# Autodesk Inventor assembly: full_adder
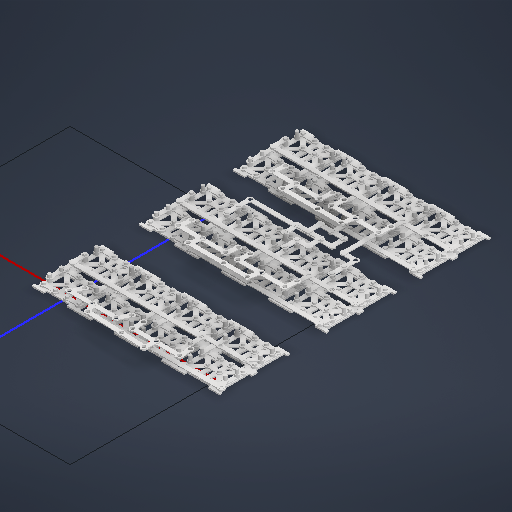
[picture p0: Inventor's stored thumbnail of the model, 512x512]
Saved by Autodesk Inventor 2025.4 (Build 294407000, 407)
## iProperties
Created: 2026-09-28
Part Number: full_adder
Document SubType Name: Assembly
Designer: User
Author: User
## Documents named in this file (3)
- G:\projects\primary\mechanical-computer\mechanics\modules\full_adder.iam
- G:\projects\primary\mechanical-computer\mechanics\gates\decoder.iam
- G:\projects\primary\mechanical-computer\mechanics\gates\gate_and-a.iam
## Components (4 placed, 2 different names)
1. decoder:1 [sub-assembly] — Flush:1, Flush:3
2. decoder:2 [sub-assembly] — Flush:1, Flush:2, Flush:3, Flush:4, Cylindrical:1, Cylindrical:2
3. decoder:3 [sub-assembly] — Flush:2, Flush:4
4. gate_and-a:1 [sub-assembly] — Cylindrical:1, Cylindrical:2
## Relationships (6: Flush 4, CylindricalJoint 2)
- Flush:1: decoder:1 ↔ decoder:2
- Flush:2: decoder:2 ↔ decoder:3
- Flush:3: decoder:1 ↔ decoder:2
- Flush:4: decoder:2 ↔ decoder:3
- Cylindrical:1: decoder:2 ↔ gate_and-a:1
- Cylindrical:2: decoder:2 ↔ gate_and-a:1
